# Autodesk Inventor assembly: Runway
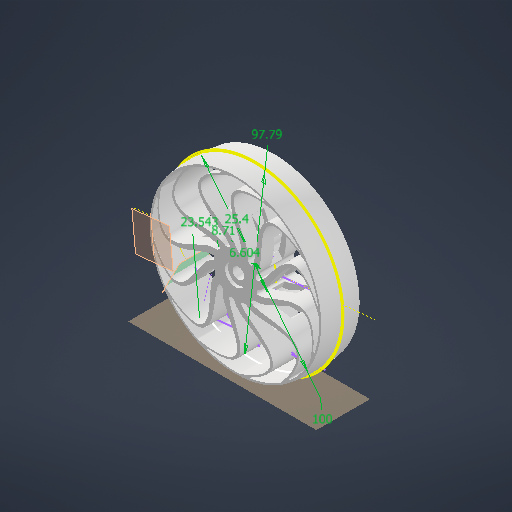
[picture p0: Inventor's stored thumbnail of the model, 512x512]
Saved by Autodesk Inventor 2027 (Build 310192060, 192F)
## iProperties
Created: 2026-07-10
Part Number: Runway
Document SubType Name: Assembly
Designer: efloy
Author: efloy
## Documents named in this file (3)
- C:\Users\efloy\Downloads\Runway.iam
- C:\Users\efloy\Downloads\12spoke_wheel.ipt
- C:\Users\efloy\Downloads\Part2.ipt
## Components (2 placed, 2 different names)
1. 12spoke_wheel:1 — Tangent:1, Mate:1
2. Part2:1 — Tangent:1
## Relationships (2: Tangent 1, Mate 1)
- Tangent:1: 12spoke_wheel:1 ↔ Part2:1
- Mate:1: 12spoke_wheel:1
